# Autodesk Inventor assembly: Screen-membrane
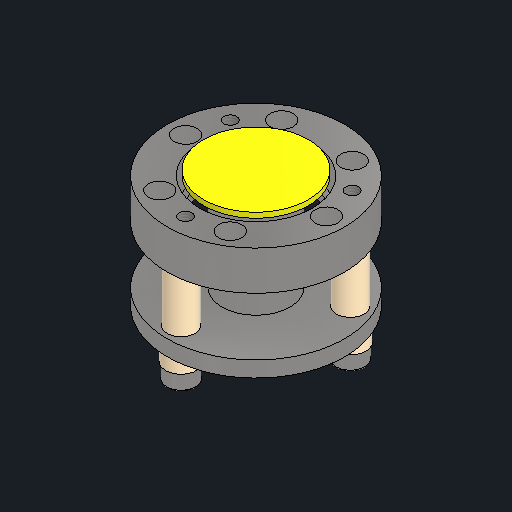
[picture p0: Inventor's stored thumbnail of the model, 512x512]
Saved by Autodesk Inventor 2027.1 (Build 311270010, 270A)
## iProperties
Created: 2026-08-19
Part Number: Screen-membrane
Document SubType Name: Assembly
Designer: rkawa
Author: rkawa
## Documents named in this file (7)
- C:\Users\queezz\Dropbox\Drawings\pihti-cad\Kawabata Probe Mods\screen-membrane\kawabata-screen-membrane.iam
- C:\Users\queezz\Dropbox\Drawings\pihti-cad\Kawabata Probe Mods\screen-membrane\kawabata-ceramic-bush.ipt
- C:\Users\queezz\Dropbox\Drawings\pihti-cad\Kawabata Probe Mods\screen-membrane\kawabata-cf34-flange.ipt
- C:\Users\queezz\Dropbox\Drawings\pihti-cad\Kawabata Probe Mods\screen-membrane\kawabata-screen-membrane-carrier.ipt
- C:\Users\queezz\Dropbox\Drawings\pihti-cad\Kawabata Probe Mods\screen-membrane\kawabata-ceramic-spacer.ipt
- C:\Users\queezz\Dropbox\Drawings\pihti-cad\Kawabata Probe Mods\screen-membrane\kawabata-membrane.ipt
- C:\Users\queezz\Dropbox\Drawings\pihti-cad\ContentCenter\Fastners\M3x8-SHCS.ipt
## Components (12 placed, 6 different names)
1. ICF34_frange:1 — Mate:2, Rotational:3, Cylindrical:1
2. Screen-membrane:1 — Rotational:1, Rotational:2, Mate:2, Cylindrical:1
3. kawabata-membrane:1 — Rotational:3
4. SS ISO 4762 M3 x 8:1 — Rotational:4
5. SS ISO 4762 M3 x 8:2 — Rotational:6
6. SS ISO 4762 M3 x 8:3 — Rotational:5
7. kawabata-ceramic-bush:1 — Rotational:1, Rotational:5
8. Ceramics-spacer:1 — Rotational:2
9. kawabata-ceramic-bush:2 — Rotational:6
10. Ceramics-spacer:2
11. kawabata-ceramic-bush:3 — Rotational:4
12. Ceramics-spacer:3
## Component patterns: (3 elements, first: kawabata-ceramic-bush:1 + Ceramics-spacer:1)
## Relationships (8: RevoluteJoint 6, Mate 1, CylindricalJoint 1)
- Rotational:1 [RevoluteJoint]: Screen-membrane:1 ↔ kawabata-ceramic-bush:1
- Rotational:2 [RevoluteJoint]: Screen-membrane:1 ↔ Ceramics-spacer:1
- Mate:2: ICF34_frange:1 ↔ Screen-membrane:1
- Rotational:3 [RevoluteJoint]: ICF34_frange:1 ↔ kawabata-membrane:1
- Cylindrical:1: ICF34_frange:1 ↔ Screen-membrane:1
- Rotational:4 [RevoluteJoint]: SS ISO 4762 M3 x 8:1 ↔ kawabata-ceramic-bush:3
- Rotational:5 [RevoluteJoint]: SS ISO 4762 M3 x 8:3 ↔ kawabata-ceramic-bush:1
- Rotational:6 [RevoluteJoint]: SS ISO 4762 M3 x 8:2 ↔ kawabata-ceramic-bush:2
